# Autodesk Inventor assembly: Assembly1
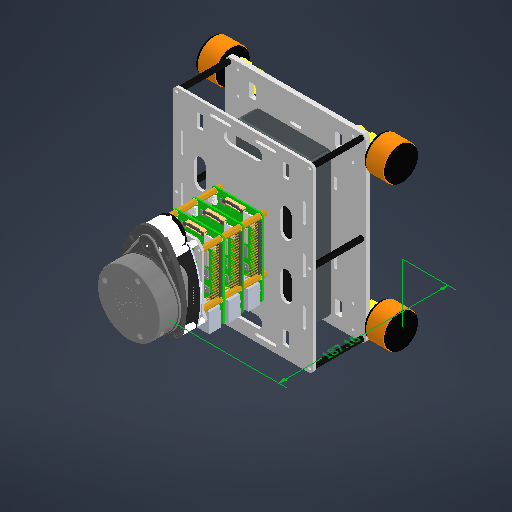
[picture p0: Inventor's stored thumbnail of the model, 512x512]
Saved by Autodesk Inventor 2026.3 (Build 303398000, 398)
## iProperties
Created: 2026-07-17
Part Number: Assembly1
Document SubType Name: Assembly
Designer: nose
Author: nose
## Documents named in this file (15)
- C:\Workspace\summer_robotics_project\TEST\CAD\SIMPLE\Assembly1.iam
- C:\Workspace\summer_robotics_project\TEST\CAD\SIMPLE\Base.ipt
- Base.ipt
- C:\Workspace\summer_robotics_project\TEST\CAD\SIMPLE\Download\MScIR_WingedMotorHolder-tightened-rearremoved.ipt
- C:\Workspace\summer_robotics_project\TEST\CAD\SIMPLE\Download\hex-spacers-m3-female-female-1.snapshot.3\Hex Spacer FF M3 L55mm\Hex Spacer FF M3 L55mm.ipt
- C:\Workspace\summer_robotics_project\TEST\CAD\SIMPLE\Top.ipt
- C:\Workspace\summer_robotics_project\TEST\CAD\SIMPLE\Download\hexagonal-spacers-m2-5-m-f-hex-5-1.snapshot.1\hexagonal_spacer_MF_M2.5_H05_HEX5_FTD3_MTL6\hexagonal_spacer_MF_M2.5_H05_HEX5_FTD3_MTL6.ipt
- C:\Workspace\summer_robotics_project\TEST\CAD\SIMPLE\Download\Raspberry Pi 4 Model B.ipt
- C:\Workspace\summer_robotics_project\TEST\CAD\SIMPLE\Download\hexagonal-spacers-m2-5-m-f-hex-5-1.snapshot.1\hexagonal_spacer_MF_M2.5_H20_HEX5_FTD6_MTL6\hexagonal_spacer_MF_M2.5_H20_HEX5_FTD6_MTL6.ipt
- C:\Workspace\summer_robotics_project\TEST\CAD\SIMPLE\Rpi_Rplidar_mount.ipt
- C:\Workspace\summer_robotics_project\TEST\CAD\SIMPLE\Download\RP-lidar-A1\RP-lidar-A1.iam
- C:\Workspace\summer_robotics_project\TEST\CAD\SIMPLE\Download\Pololu_MMG_Motor.ipt
- C:\Workspace\summer_robotics_project\TEST\CAD\SIMPLE\35mm_wheel.ipt
- C:\Workspace\summer_robotics_project\TEST\CAD\SIMPLE\powerbank_537.ipt
- C:\Workspace\summer_robotics_project\TEST\CAD\SIMPLE\Download\EAFU Battery.ipt
## Components (43 placed, 13 different names)
1. Hex Spacer FF M3 L55mm:5 — Insert:36
2. Hex Spacer FF M3 L55mm:6 — Insert:37
3. Base:1 — Insert:1, Mate:1, Insert:2, Mate:2, Insert:3, Mate:3, Insert:4, Insert:5, Insert:6, Insert:7, Insert:8, Insert:9, Mate:10, Mate:11, Mate:12, Insert:36, Insert:37
4. EAFU Battery:1 — Mate:13
5. powerbank_537:1 — Mate:10, Mate:11, Mate:12, Mate:13
6. Hex Spacer FF M3 L55mm:1 — Insert:6
7. Hex Spacer FF M3 L55mm:2 — Insert:7, Insert:38
8. Hex Spacer FF M3 L55mm:3 — Insert:8
9. Hex Spacer FF M3 L55mm:4 — Insert:9, Insert:39
10. Top:1 — Insert:12, Mate:4, Insert:13, Insert:14, Insert:38, Insert:39
11. hexagonal_spacer_MF_M2.5_H05_HEX5_FTD3_MTL6:1 — Insert:12
12. hexagonal_spacer_MF_M2.5_H05_HEX5_FTD3_MTL6:2 — Mate:4, Insert:15
13. hexagonal_spacer_MF_M2.5_H05_HEX5_FTD3_MTL6:3 — Insert:13
14. hexagonal_spacer_MF_M2.5_H05_HEX5_FTD3_MTL6:4 — Insert:14, Insert:16
15. Raspberry Pi 4 Model B:1 — Insert:15, Insert:16, Insert:17, Mate:5, Insert:18, Insert:19
16. Raspberry Pi 4 Model B:2 — Insert:20, Mate:6, Insert:21, Insert:22, Insert:23, Insert:24
17. hexagonal_spacer_MF_M2.5_H20_HEX5_FTD6_MTL6:1 — Mate:5
18. hexagonal_spacer_MF_M2.5_H20_HEX5_FTD6_MTL6:2 — Insert:17, Insert:20
19. hexagonal_spacer_MF_M2.5_H20_HEX5_FTD6_MTL6:3 — Insert:18
20. hexagonal_spacer_MF_M2.5_H20_HEX5_FTD6_MTL6:4 — Insert:19, Mate:6
21. Raspberry Pi 4 Model B:3 — Insert:25, Mate:7, Insert:26, Insert:27, Insert:28, Insert:29
22. hexagonal_spacer_MF_M2.5_H20_HEX5_FTD6_MTL6:5 — Insert:23, Mate:7
23. hexagonal_spacer_MF_M2.5_H20_HEX5_FTD6_MTL6:6 — Insert:24
24. hexagonal_spacer_MF_M2.5_H20_HEX5_FTD6_MTL6:7 — Insert:21, Insert:25
25. hexagonal_spacer_MF_M2.5_H20_HEX5_FTD6_MTL6:8 — Insert:22
26. hexagonal_spacer_MF_M2.5_H20_HEX5_FTD6_MTL6:9 — Insert:29
27. hexagonal_spacer_MF_M2.5_H20_HEX5_FTD6_MTL6:10 — Insert:28, Insert:30
28. hexagonal_spacer_MF_M2.5_H20_HEX5_FTD6_MTL6:11 — Insert:27, Mate:8
29. hexagonal_spacer_MF_M2.5_H20_HEX5_FTD6_MTL6:12 — Insert:26, Insert:40
30. Rpi_Rplidar_mount:1 — Mate:8, Insert:30, Insert:31, Mate:9, Insert:40
31. RP-lidar-A1:1 [sub-assembly] — Insert:31, Mate:9
32. MScIR_WingedMotorHolder-tightened-rearremoved:4 — Insert:1, Mate:1, Insert:33
33. 35mm_wheel:2 — Rotational:3
34. Pololu_MMG_Motor:2 — Insert:33, Rotational:3
35. MScIR_WingedMotorHolder-tightened-rearremoved:5 — Insert:2, Mate:2, Insert:34
36. 35mm_wheel:4 — Rotational:4
37. Pololu_MMG_Motor:3 — Insert:34, Rotational:4
38. MScIR_WingedMotorHolder-tightened-rearremoved:6 — Insert:3, Mate:3, Insert:32
39. 35mm_wheel:1 — Rotational:2
40. Pololu_MMG_Motor:1 — Insert:32, Rotational:2
41. MScIR_WingedMotorHolder-tightened-rearremoved:7 — Insert:4, Insert:5, Insert:35
42. 35mm_wheel:3 — Rotational:1
43. Pololu_MMG_Motor:4 — Insert:35, Rotational:1
## Relationships (55: Insert 38, Mate 13, RevoluteJoint 4)
- Insert:1: Base:1 ↔ MScIR_WingedMotorHolder-tightened-rearremoved:4
- Mate:1: Base:1 ↔ MScIR_WingedMotorHolder-tightened-rearremoved:4
- Insert:2: Base:1 ↔ MScIR_WingedMotorHolder-tightened-rearremoved:5
- Mate:2: Base:1 ↔ MScIR_WingedMotorHolder-tightened-rearremoved:5
- Insert:3: Base:1 ↔ MScIR_WingedMotorHolder-tightened-rearremoved:6
- Mate:3: Base:1 ↔ MScIR_WingedMotorHolder-tightened-rearremoved:6
- Insert:4: Base:1 ↔ MScIR_WingedMotorHolder-tightened-rearremoved:7
- Insert:5: Base:1 ↔ MScIR_WingedMotorHolder-tightened-rearremoved:7
- Insert:6: Base:1 ↔ Hex Spacer FF M3 L55mm:1
- Insert:7: Base:1 ↔ Hex Spacer FF M3 L55mm:2
- Insert:8: Base:1 ↔ Hex Spacer FF M3 L55mm:3
- Insert:9: Base:1 ↔ Hex Spacer FF M3 L55mm:4
- Insert:12: Top:1 ↔ hexagonal_spacer_MF_M2.5_H05_HEX5_FTD3_MTL6:1
- Mate:4: Top:1 ↔ hexagonal_spacer_MF_M2.5_H05_HEX5_FTD3_MTL6:2
- Insert:13: Top:1 ↔ hexagonal_spacer_MF_M2.5_H05_HEX5_FTD3_MTL6:3
- Insert:14: Top:1 ↔ hexagonal_spacer_MF_M2.5_H05_HEX5_FTD3_MTL6:4
- Insert:15: hexagonal_spacer_MF_M2.5_H05_HEX5_FTD3_MTL6:2 ↔ Raspberry Pi 4 Model B:1
- Insert:16: hexagonal_spacer_MF_M2.5_H05_HEX5_FTD3_MTL6:4 ↔ Raspberry Pi 4 Model B:1
- Insert:17: Raspberry Pi 4 Model B:1 ↔ hexagonal_spacer_MF_M2.5_H20_HEX5_FTD6_MTL6:2
- Mate:5: Raspberry Pi 4 Model B:1 ↔ hexagonal_spacer_MF_M2.5_H20_HEX5_FTD6_MTL6:1
- Insert:18: Raspberry Pi 4 Model B:1 ↔ hexagonal_spacer_MF_M2.5_H20_HEX5_FTD6_MTL6:3
- Insert:19: Raspberry Pi 4 Model B:1 ↔ hexagonal_spacer_MF_M2.5_H20_HEX5_FTD6_MTL6:4
- Insert:20: Raspberry Pi 4 Model B:2 ↔ hexagonal_spacer_MF_M2.5_H20_HEX5_FTD6_MTL6:2
- Mate:6: Raspberry Pi 4 Model B:2 ↔ hexagonal_spacer_MF_M2.5_H20_HEX5_FTD6_MTL6:4
- Insert:21: Raspberry Pi 4 Model B:2 ↔ hexagonal_spacer_MF_M2.5_H20_HEX5_FTD6_MTL6:7
- Insert:22: Raspberry Pi 4 Model B:2 ↔ hexagonal_spacer_MF_M2.5_H20_HEX5_FTD6_MTL6:8
- Insert:23: Raspberry Pi 4 Model B:2 ↔ hexagonal_spacer_MF_M2.5_H20_HEX5_FTD6_MTL6:5
- Insert:24: Raspberry Pi 4 Model B:2 ↔ hexagonal_spacer_MF_M2.5_H20_HEX5_FTD6_MTL6:6
- Insert:25: Raspberry Pi 4 Model B:3 ↔ hexagonal_spacer_MF_M2.5_H20_HEX5_FTD6_MTL6:7
- Mate:7: Raspberry Pi 4 Model B:3 ↔ hexagonal_spacer_MF_M2.5_H20_HEX5_FTD6_MTL6:5
- Insert:26: Raspberry Pi 4 Model B:3 ↔ hexagonal_spacer_MF_M2.5_H20_HEX5_FTD6_MTL6:12
- Insert:27: Raspberry Pi 4 Model B:3 ↔ hexagonal_spacer_MF_M2.5_H20_HEX5_FTD6_MTL6:11
- Insert:28: Raspberry Pi 4 Model B:3 ↔ hexagonal_spacer_MF_M2.5_H20_HEX5_FTD6_MTL6:10
- Insert:29: Raspberry Pi 4 Model B:3 ↔ hexagonal_spacer_MF_M2.5_H20_HEX5_FTD6_MTL6:9
- Mate:8: hexagonal_spacer_MF_M2.5_H20_HEX5_FTD6_MTL6:11 ↔ Rpi_Rplidar_mount:1
- Insert:30: hexagonal_spacer_MF_M2.5_H20_HEX5_FTD6_MTL6:10 ↔ Rpi_Rplidar_mount:1
- Insert:31: Rpi_Rplidar_mount:1 ↔ RP-lidar-A1:1
- Mate:9: Rpi_Rplidar_mount:1 ↔ RP-lidar-A1:1
- Insert:32: MScIR_WingedMotorHolder-tightened-rearremoved:6 ↔ Pololu_MMG_Motor:1
- Insert:33: MScIR_WingedMotorHolder-tightened-rearremoved:4 ↔ Pololu_MMG_Motor:2
- Insert:34: MScIR_WingedMotorHolder-tightened-rearremoved:5 ↔ Pololu_MMG_Motor:3
- Insert:35: MScIR_WingedMotorHolder-tightened-rearremoved:7 ↔ Pololu_MMG_Motor:4
- Rotational:1 [RevoluteJoint]: 35mm_wheel:3 ↔ Pololu_MMG_Motor:4
- Rotational:2 [RevoluteJoint]: 35mm_wheel:1 ↔ Pololu_MMG_Motor:1
- Rotational:3 [RevoluteJoint]: 35mm_wheel:2 ↔ Pololu_MMG_Motor:2
- Rotational:4 [RevoluteJoint]: 35mm_wheel:4 ↔ Pololu_MMG_Motor:3
- Mate:10: Base:1 ↔ powerbank_537:1
- Mate:11: Base:1 ↔ powerbank_537:1
- Mate:12: Base:1 ↔ powerbank_537:1
- Mate:13: EAFU Battery:1 ↔ powerbank_537:1
- Insert:36: Hex Spacer FF M3 L55mm:5 ↔ Base:1
- Insert:37: Hex Spacer FF M3 L55mm:6 ↔ Base:1
- Insert:38: Hex Spacer FF M3 L55mm:2 ↔ Top:1
- Insert:39: Hex Spacer FF M3 L55mm:4 ↔ Top:1
- Insert:40: hexagonal_spacer_MF_M2.5_H20_HEX5_FTD6_MTL6:12 ↔ Rpi_Rplidar_mount:1
